# Autodesk Inventor assembly: Assembly1
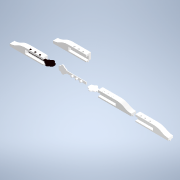
[picture p0: Inventor's stored thumbnail of the model, 180x180]
Saved by Autodesk Inventor 2020 (Build 240168000, 168)
## iProperties
Created: 2022-06-23
Part Number: Assembly1
Document SubType Name: Assembly
Designer: drago
Author: drago
## Documents named in this file (8)
- C:\Users\drago\Documents\ULTIMA_VARIANTA\chei\Assembly1.iam
- C:\Users\drago\Documents\ULTIMA_VARIANTA\Broasca\Broascav1\P2_V1_001.ipt
- C:\Users\drago\Documents\ULTIMA_VARIANTA\Broasca\Broascav2\P2_V2_001.ipt
- C:\Users\drago\Documents\ULTIMA_VARIANTA\Broasca\Broascav3\P2_V3_001.ipt
- C:\Users\drago\Documents\ULTIMA_VARIANTA\Broasca\Broascav4\P2_V4_001.ipt
- C:\Users\drago\Documents\ULTIMA_VARIANTA\chei\cheie_v1.ipt
- C:\Users\drago\Documents\ULTIMA_VARIANTA\chei\cheie_v2_corect.ipt
- C:\Users\drago\Documents\ULTIMA_VARIANTA\chei\cheie_v3_corect.ipt
## Components (7 placed, 7 different names)
1. P2_V1_001:1 — Mate:1, Mate:2, Mate:3, Mate:6
2. P2_V2_001:1
3. P2_V3_001:1 — Mate:7, Mate:8, Mate:9
4. P2_V4_001:1
5. cheie_v1:1 — Mate:1, Mate:2, Mate:3, Mate:6
6. cheie_v3_corect:1 — Mate:7, Mate:8, Mate:9
7. cheie_v2_corect:1
## Relationships (7: Mate 7)
- Mate:1: P2_V1_001:1 ↔ cheie_v1:1
- Mate:2: P2_V1_001:1 ↔ cheie_v1:1
- Mate:3: P2_V1_001:1 ↔ cheie_v1:1
- Mate:6: P2_V1_001:1 ↔ cheie_v1:1
- Mate:7: P2_V3_001:1 ↔ cheie_v3_corect:1
- Mate:8: P2_V3_001:1 ↔ cheie_v3_corect:1
- Mate:9: P2_V3_001:1 ↔ cheie_v3_corect:1
